# Autodesk Inventor assembly: halfdrivetrain_MIR
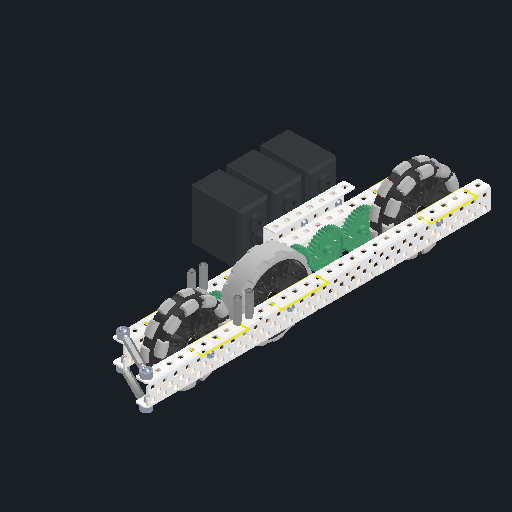
[picture p0: Inventor's stored thumbnail of the model, 512x512]
Saved by Autodesk Inventor 2026.2 (Build 302298000, 298)
## iProperties
Created: 2026-11-04
Part Number: halfdrivetrain_MIR
Document SubType Name: Assembly
Designer: BuddyProject
Author: BuddyProject
## Documents named in this file (27)
- E:\593C-CAD-26-27\Mirrored Parts\halfdrivetrain_MIR.iam
- E:\593C-CAD-26-27\Mirrored Parts\3.25 Omni AS, No Insert_MIR.iam
- E:\593C-CAD-26-27\Mirrored Parts\HS Shaft Adapter Circle_MIR.ipt
- E:\593C-CAD-26-27\Mirrored Parts\HS 48T Gear, No Insert_MIR.iam
- E:\593C-CAD-26-27\Mirrored Parts\3.25 Traction AS, No Insert_MIR.iam
- E:\593C-CAD-26-27\Mirrored Parts\Alu C 1x2x1x25_MIR.ipt
- E:\593C-CAD-26-27\Mirrored Parts\Alu C 1x2x1x30_MIR.ipt
- E:\593C-CAD-26-27\Mirrored Parts\dtmotorsub_MIR.iam
- E:\VEX-CAD-Inventor-main\Structure\Standoff\Standoff 1.00.ipt
- E:\VEX-CAD-Inventor-main\Structure\Standoff.ipt
- E:\593C-CAD-26-27\Mirrored Parts\Bearing Flat - Shaved_MIR.ipt
- E:\593C-CAD-26-27\Mirrored Parts\Bearing Flat - ShavedCut_MIR.ipt
- E:\593C-CAD-26-27\Mirrored Parts\Bearing Flat_MIR.ipt
- E:\VEX-CAD-Inventor-main\Structure\Hardware\Screw Steel - Star\SScrew Star Threaded 2.500.ipt
- E:\VEX-CAD-Inventor-main\Structure\Hardware\Screw Steel - Star.ipt
- E:\VEX-CAD-Inventor-main\Motion\Spacers\Spacer Nylon .375 OD\NSpacer .375 OD x .500.ipt
- E:\VEX-CAD-Inventor-main\Motion\Spacers\Spacer Nylon .375 OD.ipt
- E:\VEX-CAD-Inventor-main\Motion\Spacers\Washer Steel\SWasher .375 OD x .031250.ipt
- E:\VEX-CAD-Inventor-main\Motion\Spacers\Washer Steel.ipt
- E:\VEX-CAD-Inventor-main\Motion\Spacers\Spacer Nylon .375 OD\NSpacer .375 OD x .125.ipt
- E:\VEX-CAD-Inventor-main\Motion\Spacers\Spacer Nylon .375 OD\NSpacer .375 OD x .250.ipt
- E:\593C-CAD-26-27\Mirrored Parts\LS 36T Gear_MIR.ipt
- E:\593C-CAD-26-27\Mirrored Parts\Shaft Collar No Screw_MIR.ipt
- E:\VEX-CAD-Inventor-main\Structure\Hardware\Coupler\Coupler Star 1.ipt
- E:\VEX-CAD-Inventor-main\Structure\Hardware\Coupler.ipt
- E:\VEX-CAD-Inventor-main\Structure\Standoff\Standoff 1.50.ipt
- E:\VEX-CAD-Inventor-main\Structure\Hardware\Screw Steel - Star\SScrew Star Smooth .500.ipt
## Components (73 placed, 21 different names)
1. 3.25 Omni AS, No Insert_MIR:1 [sub-assembly] — Mate:2, Mate:1, Mate:129, Mate:5, Mate:96
2. HS Shaft Adapter Circle_MIR:1 — Mate:2, Mate:1, Mate:4
3. HS 48T Gear, No Insert_MIR:1 [sub-assembly] — Mate:129, Mate:5, Flush:1, Mate:3, Mate:98, Rotation:3
4. HS Shaft Adapter Circle_MIR:2 — Mate:4, Flush:1, Mate:3, Mate:95
5. 3.25 Omni AS, No Insert_MIR:2 [sub-assembly] — Mate:7, Mate:6, Mate:131, Mate:10, Mate:76
6. HS Shaft Adapter Circle_MIR:3 — Mate:7, Mate:6, Mate:9, Mate:75
7. HS 48T Gear, No Insert_MIR:2 [sub-assembly] — Mate:131, Mate:10, Flush:2, Mate:8, Mate:78, Rotation:6
8. HS Shaft Adapter Circle_MIR:4 — Mate:9, Flush:2, Mate:8
9. 3.25 Traction AS, No Insert_MIR:1 [sub-assembly] — Flush:3, Mate:11, Mate:130, Mate:14, Mate:94
10. HS Shaft Adapter Circle_MIR:5 — Flush:3, Mate:11, Mate:13
11. HS 48T Gear, No Insert_MIR:3 [sub-assembly] — Mate:130, Mate:14, Flush:4, Mate:12, Mate:100, Rotation:4, Rotation:5
12. HS Shaft Adapter Circle_MIR:6 — Mate:13, Flush:4, Mate:12, Mate:93
13. Alu C 1x2x1x25_MIR:1 — Mate:28, Mate:23, Mate:27, Mate:31, Mate:30, Mate:29, Mate:34, Mate:33, Mate:32, Mate:37, Mate:36, Mate:35, Mate:40, Mate:39, Mate:38, Mate:43, Mate:42, Mate:41, Mate:46, Mate:45, Mate:44, Mate:116, Mate:58, Mate:124, Mate:128, Mate:127, Mate:133, Mate:132, Mate:126, Mate:125, Mate:144, Mate:162, Mate:164
14. Alu C 1x2x1x30_MIR:1 — Mate:25, Mate:26, Mate:24, Mate:52, Mate:51, Mate:50, Mate:62, Mate:61, Mate:54, Mate:53, Mate:64, Mate:63, Mate:57, Mate:60, Mate:59, Mate:56, Mate:55, Mate:66, Mate:70, Mate:68, Mate:141, Mate:140, Mate:161, Mate:163
15. dtmotorsub_MIR:1 [sub-assembly] — Mate:122, Mate:121, Mate:109
16. Standoff 1.00:1 — Mate:25
17. Standoff 1.00:2 — Mate:28, Mate:23
18. Standoff 1.00:3 — Mate:26
19. Standoff 1.00:4 — Mate:27, Mate:24
20. Bearing Flat - Shaved_MIR:1 — Mate:31, Mate:30, Mate:29
21. Bearing Flat - Shaved_MIR:2 — Mate:34, Mate:33, Mate:32
22. Bearing Flat - ShavedCut_MIR:1 — Mate:37, Mate:36, Mate:35
23. Bearing Flat_MIR:1 — Mate:40, Mate:39, Mate:38
24. Bearing Flat_MIR:2 — Mate:43, Mate:42, Mate:41, Mate:123
25. Bearing Flat_MIR:3 — Mate:46, Mate:45, Mate:44, Mate:104, Mate:103
26. Bearing Flat - Shaved_MIR:3 — Mate:52, Mate:51, Mate:50, Mate:65, Mate:72
27. Bearing Flat_MIR:4 — Mate:62, Mate:61
28. Bearing Flat - Shaved_MIR:4 — Mate:54, Mate:53, Mate:67, Mate:87
29. Bearing Flat_MIR:5 — Mate:64, Mate:63
30. Bearing Flat_MIR:6 — Mate:116, Mate:58, Mate:57, Mate:102, Mate:101
31. Bearing Flat_MIR:7 — Mate:60, Mate:59
32. Bearing Flat - Shaved_MIR:5 — Mate:56, Mate:55, Mate:69, Mate:88
33. SScrew Star Threaded 2.500:1 — Mate:75, Mate:66, Mate:65, Mate:71, Mate:73, Mate:77, Mate:79
34. SScrew Star Threaded 2.500:2 — Mate:95, Mate:70, Mate:69, Mate:86, Mate:97
35. SScrew Star Threaded 2.500:3 — Mate:93, Mate:68, Mate:67, Mate:85, Mate:99
36. NSpacer .375 OD x .500:1 — Mate:72, Mate:71, Mate:74
37. SWasher .375 OD x .031250:1 — Mate:76, Mate:74, Mate:73
38. NSpacer .375 OD x .125:2 — Mate:78, Mate:77, Mate:80
39. SWasher .375 OD x .031250:2 — Mate:80, Mate:79
40. NSpacer .375 OD x .500:3 — Mate:87, Mate:85, Mate:82, Mate:81
41. SWasher .375 OD x .031250:3 — Mate:94, Mate:82, Mate:81
42. NSpacer .375 OD x .500:4 — Mate:88, Mate:86, Mate:84, Mate:83
43. SWasher .375 OD x .031250:4 — Mate:96, Mate:84, Mate:83
44. NSpacer .375 OD x .125:5 — Mate:100, Mate:99, Mate:90, Mate:89
45. SWasher .375 OD x .031250:5 — Mate:90, Mate:89
46. NSpacer .375 OD x .125:6 — Mate:98, Mate:97, Mate:92, Mate:91
47. SWasher .375 OD x .031250:6 — Mate:92, Mate:91
48. NSpacer .375 OD x .250:7 — Mate:122, Mate:104, Mate:103, Mate:108, Mate:107, Mate:114, Mate:119
49. NSpacer .375 OD x .250:8 — Mate:102, Mate:101, Mate:106, Mate:105, Mate:112, Mate:118
50. SWasher .375 OD x .031250:7 — Mate:106, Mate:105, Mate:111
51. SWasher .375 OD x .031250:8 — Mate:108, Mate:107, Mate:113
52. SWasher .375 OD x .031250:9 — Mate:112, Mate:111, Mate:117
53. SWasher .375 OD x .031250:10 — Mate:114, Mate:113, Mate:120
54. SWasher .375 OD x .031250:11 — Mate:121, Mate:109, Mate:118, Mate:117
55. SWasher .375 OD x .031250:12 — Mate:120, Mate:119
56. LS 36T Gear_MIR:1 — Rotation:3, Mate:124, Mate:123, Rotation:1
57. LS 36T Gear_MIR:2 — Rotation:4, Mate:128, Mate:127, Rotation:2
58. LS 36T Gear_MIR:3 — Rotation:6, Rotation:5, Mate:133, Mate:132
59. LS 36T Gear_MIR:4 — Rotation:2, Rotation:1, Mate:126, Mate:125
60. Shaft Collar No Screw_MIR:1 — Mate:135, Mate:134, Mate:146, Mate:145
61. Coupler Star 1:1 — Mate:135, Mate:134, Mate:148
62. Standoff 1.50:5 — Mate:148, Mate:149, Mate:147
63. Shaft Collar No Screw_MIR:2 — Mate:149, Mate:141, Mate:137, Mate:136, Mate:143, Mate:142
64. Coupler Star 1:2 — Mate:147, Mate:137, Mate:136
65. SScrew Star Smooth .500:4 — Mate:143, Mate:142, Mate:140
66. SScrew Star Smooth .500:5 — Mate:146, Mate:145, Mate:144
67. Shaft Collar No Screw_MIR:3 — Mate:162, Mate:151, Mate:150, Mate:157, Mate:156
68. Coupler Star 1:3 — Mate:151, Mate:150, Mate:159
69. Standoff 1.50:6 — Mate:159, Mate:160, Mate:158
70. Shaft Collar No Screw_MIR:4 — Mate:161, Mate:160, Mate:153, Mate:152, Mate:155, Mate:154
71. Coupler Star 1:4 — Mate:153, Mate:152, Mate:158
72. SScrew Star Smooth .500:6 — Mate:163, Mate:155, Mate:154
73. SScrew Star Smooth .500:7 — Mate:164, Mate:157, Mate:156
## Relationships (159: Mate 149, RelateRotation 6, Flush 4)
- Mate:2: 3.25 Omni AS, No Insert_MIR:1 ↔ HS Shaft Adapter Circle_MIR:1
- Mate:1: 3.25 Omni AS, No Insert_MIR:1 ↔ HS Shaft Adapter Circle_MIR:1
- Mate:129: 3.25 Omni AS, No Insert_MIR:1 ↔ HS 48T Gear, No Insert_MIR:1
- Mate:5: 3.25 Omni AS, No Insert_MIR:1 ↔ HS 48T Gear, No Insert_MIR:1
- Mate:4: HS Shaft Adapter Circle_MIR:1 ↔ HS Shaft Adapter Circle_MIR:2
- Flush:1: HS 48T Gear, No Insert_MIR:1 ↔ HS Shaft Adapter Circle_MIR:2
- Mate:3: HS 48T Gear, No Insert_MIR:1 ↔ HS Shaft Adapter Circle_MIR:2
- Mate:7: 3.25 Omni AS, No Insert_MIR:2 ↔ HS Shaft Adapter Circle_MIR:3
- Mate:6: 3.25 Omni AS, No Insert_MIR:2 ↔ HS Shaft Adapter Circle_MIR:3
- Mate:131: 3.25 Omni AS, No Insert_MIR:2 ↔ HS 48T Gear, No Insert_MIR:2
- Mate:10: 3.25 Omni AS, No Insert_MIR:2 ↔ HS 48T Gear, No Insert_MIR:2
- Mate:9: HS Shaft Adapter Circle_MIR:3 ↔ HS Shaft Adapter Circle_MIR:4
- Flush:2: HS 48T Gear, No Insert_MIR:2 ↔ HS Shaft Adapter Circle_MIR:4
- Mate:8: HS 48T Gear, No Insert_MIR:2 ↔ HS Shaft Adapter Circle_MIR:4
- Flush:3: 3.25 Traction AS, No Insert_MIR:1 ↔ HS Shaft Adapter Circle_MIR:5
- Mate:11: 3.25 Traction AS, No Insert_MIR:1 ↔ HS Shaft Adapter Circle_MIR:5
- Mate:130: 3.25 Traction AS, No Insert_MIR:1 ↔ HS 48T Gear, No Insert_MIR:3
- Mate:14: 3.25 Traction AS, No Insert_MIR:1 ↔ HS 48T Gear, No Insert_MIR:3
- Mate:13: HS Shaft Adapter Circle_MIR:5 ↔ HS Shaft Adapter Circle_MIR:6
- Flush:4: HS 48T Gear, No Insert_MIR:3 ↔ HS Shaft Adapter Circle_MIR:6
- Mate:12: HS 48T Gear, No Insert_MIR:3 ↔ HS Shaft Adapter Circle_MIR:6
- Mate:25: Alu C 1x2x1x30_MIR:1 ↔ Standoff 1.00:1
- Mate:28: Alu C 1x2x1x25_MIR:1 ↔ Standoff 1.00:2
- Mate:23: Alu C 1x2x1x25_MIR:1 ↔ Standoff 1.00:2
- Mate:26: Alu C 1x2x1x30_MIR:1 ↔ Standoff 1.00:3
- Mate:27: Alu C 1x2x1x25_MIR:1 ↔ Standoff 1.00:4
- Mate:24: Alu C 1x2x1x30_MIR:1 ↔ Standoff 1.00:4
- Mate:31: Alu C 1x2x1x25_MIR:1 ↔ Bearing Flat - Shaved_MIR:1
- Mate:30: Alu C 1x2x1x25_MIR:1 ↔ Bearing Flat - Shaved_MIR:1
- Mate:29: Alu C 1x2x1x25_MIR:1 ↔ Bearing Flat - Shaved_MIR:1
- Mate:34: Alu C 1x2x1x25_MIR:1 ↔ Bearing Flat - Shaved_MIR:2
- Mate:33: Alu C 1x2x1x25_MIR:1 ↔ Bearing Flat - Shaved_MIR:2
- Mate:32: Alu C 1x2x1x25_MIR:1 ↔ Bearing Flat - Shaved_MIR:2
- Mate:37: Alu C 1x2x1x25_MIR:1 ↔ Bearing Flat - ShavedCut_MIR:1
- Mate:36: Alu C 1x2x1x25_MIR:1 ↔ Bearing Flat - ShavedCut_MIR:1
- Mate:35: Alu C 1x2x1x25_MIR:1 ↔ Bearing Flat - ShavedCut_MIR:1
- Mate:40: Alu C 1x2x1x25_MIR:1 ↔ Bearing Flat_MIR:1
- Mate:39: Alu C 1x2x1x25_MIR:1 ↔ Bearing Flat_MIR:1
- Mate:38: Alu C 1x2x1x25_MIR:1 ↔ Bearing Flat_MIR:1
- Mate:43: Alu C 1x2x1x25_MIR:1 ↔ Bearing Flat_MIR:2
- Mate:42: Alu C 1x2x1x25_MIR:1 ↔ Bearing Flat_MIR:2
- Mate:41: Alu C 1x2x1x25_MIR:1 ↔ Bearing Flat_MIR:2
- Mate:46: Alu C 1x2x1x25_MIR:1 ↔ Bearing Flat_MIR:3
- Mate:45: Alu C 1x2x1x25_MIR:1 ↔ Bearing Flat_MIR:3
- Mate:44: Alu C 1x2x1x25_MIR:1 ↔ Bearing Flat_MIR:3
- Mate:52: Alu C 1x2x1x30_MIR:1 ↔ Bearing Flat - Shaved_MIR:3
- Mate:51: Alu C 1x2x1x30_MIR:1 ↔ Bearing Flat - Shaved_MIR:3
- Mate:50: Alu C 1x2x1x30_MIR:1 ↔ Bearing Flat - Shaved_MIR:3
- Mate:62: Alu C 1x2x1x30_MIR:1 ↔ Bearing Flat_MIR:4
- Mate:61: Alu C 1x2x1x30_MIR:1 ↔ Bearing Flat_MIR:4
- Mate:54: Alu C 1x2x1x30_MIR:1 ↔ Bearing Flat - Shaved_MIR:4
- Mate:53: Alu C 1x2x1x30_MIR:1 ↔ Bearing Flat - Shaved_MIR:4
- Mate:64: Alu C 1x2x1x30_MIR:1 ↔ Bearing Flat_MIR:5
- Mate:63: Alu C 1x2x1x30_MIR:1 ↔ Bearing Flat_MIR:5
- Mate:116: Alu C 1x2x1x25_MIR:1 ↔ Bearing Flat_MIR:6
- Mate:58: Alu C 1x2x1x25_MIR:1 ↔ Bearing Flat_MIR:6
- Mate:57: Alu C 1x2x1x30_MIR:1 ↔ Bearing Flat_MIR:6
- Mate:60: Alu C 1x2x1x30_MIR:1 ↔ Bearing Flat_MIR:7
- Mate:59: Alu C 1x2x1x30_MIR:1 ↔ Bearing Flat_MIR:7
- Mate:56: Alu C 1x2x1x30_MIR:1 ↔ Bearing Flat - Shaved_MIR:5
- Mate:55: Alu C 1x2x1x30_MIR:1 ↔ Bearing Flat - Shaved_MIR:5
- Mate:75: HS Shaft Adapter Circle_MIR:3 ↔ SScrew Star Threaded 2.500:1
- Mate:66: Alu C 1x2x1x30_MIR:1 ↔ SScrew Star Threaded 2.500:1
- Mate:65: Bearing Flat - Shaved_MIR:3 ↔ SScrew Star Threaded 2.500:1
- Mate:95: HS Shaft Adapter Circle_MIR:2 ↔ SScrew Star Threaded 2.500:2
- Mate:70: Alu C 1x2x1x30_MIR:1 ↔ SScrew Star Threaded 2.500:2
- Mate:69: Bearing Flat - Shaved_MIR:5 ↔ SScrew Star Threaded 2.500:2
- Mate:93: HS Shaft Adapter Circle_MIR:6 ↔ SScrew Star Threaded 2.500:3
- Mate:68: Alu C 1x2x1x30_MIR:1 ↔ SScrew Star Threaded 2.500:3
- Mate:67: Bearing Flat - Shaved_MIR:4 ↔ SScrew Star Threaded 2.500:3
- Mate:72: Bearing Flat - Shaved_MIR:3 ↔ NSpacer .375 OD x .500:1
- Mate:71: SScrew Star Threaded 2.500:1 ↔ NSpacer .375 OD x .500:1
- Mate:76: 3.25 Omni AS, No Insert_MIR:2 ↔ SWasher .375 OD x .031250:1
- Mate:74: NSpacer .375 OD x .500:1 ↔ SWasher .375 OD x .031250:1
- Mate:73: SScrew Star Threaded 2.500:1 ↔ SWasher .375 OD x .031250:1
- Mate:78: HS 48T Gear, No Insert_MIR:2 ↔ NSpacer .375 OD x .125:2
- Mate:77: SScrew Star Threaded 2.500:1 ↔ NSpacer .375 OD x .125:2
- Mate:80: NSpacer .375 OD x .125:2 ↔ SWasher .375 OD x .031250:2
- Mate:79: SScrew Star Threaded 2.500:1 ↔ SWasher .375 OD x .031250:2
- Mate:87: Bearing Flat - Shaved_MIR:4 ↔ NSpacer .375 OD x .500:3
- Mate:85: SScrew Star Threaded 2.500:3 ↔ NSpacer .375 OD x .500:3
- Mate:94: 3.25 Traction AS, No Insert_MIR:1 ↔ SWasher .375 OD x .031250:3
- Mate:82: NSpacer .375 OD x .500:3 ↔ SWasher .375 OD x .031250:3
- Mate:81: NSpacer .375 OD x .500:3 ↔ SWasher .375 OD x .031250:3
- Mate:88: Bearing Flat - Shaved_MIR:5 ↔ NSpacer .375 OD x .500:4
- Mate:86: SScrew Star Threaded 2.500:2 ↔ NSpacer .375 OD x .500:4
- Mate:96: 3.25 Omni AS, No Insert_MIR:1 ↔ SWasher .375 OD x .031250:4
- Mate:84: NSpacer .375 OD x .500:4 ↔ SWasher .375 OD x .031250:4
- Mate:83: NSpacer .375 OD x .500:4 ↔ SWasher .375 OD x .031250:4
- Mate:100: HS 48T Gear, No Insert_MIR:3 ↔ NSpacer .375 OD x .125:5
- Mate:99: SScrew Star Threaded 2.500:3 ↔ NSpacer .375 OD x .125:5
- Mate:90: NSpacer .375 OD x .125:5 ↔ SWasher .375 OD x .031250:5
- Mate:89: NSpacer .375 OD x .125:5 ↔ SWasher .375 OD x .031250:5
- Mate:98: HS 48T Gear, No Insert_MIR:1 ↔ NSpacer .375 OD x .125:6
- Mate:97: SScrew Star Threaded 2.500:2 ↔ NSpacer .375 OD x .125:6
- Mate:92: NSpacer .375 OD x .125:6 ↔ SWasher .375 OD x .031250:6
- Mate:91: NSpacer .375 OD x .125:6 ↔ SWasher .375 OD x .031250:6
- Mate:122: dtmotorsub_MIR:1 ↔ NSpacer .375 OD x .250:7
- Mate:104: Bearing Flat_MIR:3 ↔ NSpacer .375 OD x .250:7
- Mate:103: Bearing Flat_MIR:3 ↔ NSpacer .375 OD x .250:7
- Mate:102: Bearing Flat_MIR:6 ↔ NSpacer .375 OD x .250:8
- Mate:101: Bearing Flat_MIR:6 ↔ NSpacer .375 OD x .250:8
- Mate:106: NSpacer .375 OD x .250:8 ↔ SWasher .375 OD x .031250:7
- Mate:105: NSpacer .375 OD x .250:8 ↔ SWasher .375 OD x .031250:7
- Mate:108: NSpacer .375 OD x .250:7 ↔ SWasher .375 OD x .031250:8
- Mate:107: NSpacer .375 OD x .250:7 ↔ SWasher .375 OD x .031250:8
- Mate:112: NSpacer .375 OD x .250:8 ↔ SWasher .375 OD x .031250:9
- Mate:111: SWasher .375 OD x .031250:7 ↔ SWasher .375 OD x .031250:9
- Mate:114: NSpacer .375 OD x .250:7 ↔ SWasher .375 OD x .031250:10
- Mate:113: SWasher .375 OD x .031250:8 ↔ SWasher .375 OD x .031250:10
- Mate:121: dtmotorsub_MIR:1 ↔ SWasher .375 OD x .031250:11
- Mate:109: dtmotorsub_MIR:1 ↔ SWasher .375 OD x .031250:11
- Mate:118: NSpacer .375 OD x .250:8 ↔ SWasher .375 OD x .031250:11
- Mate:117: SWasher .375 OD x .031250:9 ↔ SWasher .375 OD x .031250:11
- Mate:120: SWasher .375 OD x .031250:10 ↔ SWasher .375 OD x .031250:12
- Mate:119: NSpacer .375 OD x .250:7 ↔ SWasher .375 OD x .031250:12
- Rotation:3 [RelateRotation] (1.6667 ul): HS 48T Gear, No Insert_MIR:1 ↔ LS 36T Gear_MIR:1
- Mate:124 (2.54 mm): Alu C 1x2x1x25_MIR:1 ↔ LS 36T Gear_MIR:1
- Mate:123: Bearing Flat_MIR:2 ↔ LS 36T Gear_MIR:1
- Rotation:4 [RelateRotation] (1.6667 ul): HS 48T Gear, No Insert_MIR:3 ↔ LS 36T Gear_MIR:2
- Mate:128 (2.54 mm): Alu C 1x2x1x25_MIR:1 ↔ LS 36T Gear_MIR:2
- Mate:127: Alu C 1x2x1x25_MIR:1 ↔ LS 36T Gear_MIR:2
- Rotation:6 [RelateRotation] (1.6667 ul): HS 48T Gear, No Insert_MIR:2 ↔ LS 36T Gear_MIR:3
- Rotation:5 [RelateRotation] (1.6667 ul): HS 48T Gear, No Insert_MIR:3 ↔ LS 36T Gear_MIR:3
- Mate:133 (2.54 mm): Alu C 1x2x1x25_MIR:1 ↔ LS 36T Gear_MIR:3
- Mate:132: Alu C 1x2x1x25_MIR:1 ↔ LS 36T Gear_MIR:3
- Rotation:2 [RelateRotation] (1 ul): LS 36T Gear_MIR:2 ↔ LS 36T Gear_MIR:4
- Rotation:1 [RelateRotation] (1 ul): LS 36T Gear_MIR:1 ↔ LS 36T Gear_MIR:4
- Mate:126 (2.54 mm): Alu C 1x2x1x25_MIR:1 ↔ LS 36T Gear_MIR:4
- Mate:125: Alu C 1x2x1x25_MIR:1 ↔ LS 36T Gear_MIR:4
- Mate:135: Shaft Collar No Screw_MIR:1 ↔ Coupler Star 1:1
- Mate:134: Shaft Collar No Screw_MIR:1 ↔ Coupler Star 1:1
- Mate:148: Coupler Star 1:1 ↔ Standoff 1.50:5
- Mate:149 (9.3472 mm): Standoff 1.50:5 ↔ Shaft Collar No Screw_MIR:2
- Mate:141: Alu C 1x2x1x30_MIR:1 ↔ Shaft Collar No Screw_MIR:2
- Mate:147: Standoff 1.50:5 ↔ Coupler Star 1:2
- Mate:137: Shaft Collar No Screw_MIR:2 ↔ Coupler Star 1:2
- Mate:136: Shaft Collar No Screw_MIR:2 ↔ Coupler Star 1:2
- Mate:143: Shaft Collar No Screw_MIR:2 ↔ SScrew Star Smooth .500:4
- Mate:142: Shaft Collar No Screw_MIR:2 ↔ SScrew Star Smooth .500:4
- Mate:140: Alu C 1x2x1x30_MIR:1 ↔ SScrew Star Smooth .500:4
- Mate:146: Shaft Collar No Screw_MIR:1 ↔ SScrew Star Smooth .500:5
- Mate:145: Shaft Collar No Screw_MIR:1 ↔ SScrew Star Smooth .500:5
- Mate:144: Alu C 1x2x1x25_MIR:1 ↔ SScrew Star Smooth .500:5
- Mate:162: Alu C 1x2x1x25_MIR:1 ↔ Shaft Collar No Screw_MIR:3
- Mate:151: Shaft Collar No Screw_MIR:3 ↔ Coupler Star 1:3
- Mate:150: Shaft Collar No Screw_MIR:3 ↔ Coupler Star 1:3
- Mate:159: Coupler Star 1:3 ↔ Standoff 1.50:6
- Mate:161: Alu C 1x2x1x30_MIR:1 ↔ Shaft Collar No Screw_MIR:4
- Mate:160 (9.3472 mm): Standoff 1.50:6 ↔ Shaft Collar No Screw_MIR:4
- Mate:153: Shaft Collar No Screw_MIR:4 ↔ Coupler Star 1:4
- Mate:152: Shaft Collar No Screw_MIR:4 ↔ Coupler Star 1:4
- Mate:158: Standoff 1.50:6 ↔ Coupler Star 1:4
- Mate:163: Alu C 1x2x1x30_MIR:1 ↔ SScrew Star Smooth .500:6
- Mate:155: Shaft Collar No Screw_MIR:4 ↔ SScrew Star Smooth .500:6
- Mate:154: Shaft Collar No Screw_MIR:4 ↔ SScrew Star Smooth .500:6
- Mate:164: Alu C 1x2x1x25_MIR:1 ↔ SScrew Star Smooth .500:7
- Mate:157: Shaft Collar No Screw_MIR:3 ↔ SScrew Star Smooth .500:7
- Mate:156: Shaft Collar No Screw_MIR:3 ↔ SScrew Star Smooth .500:7
